(part 1 of 2)
# Autodesk Inventor assembly: Z-Axis
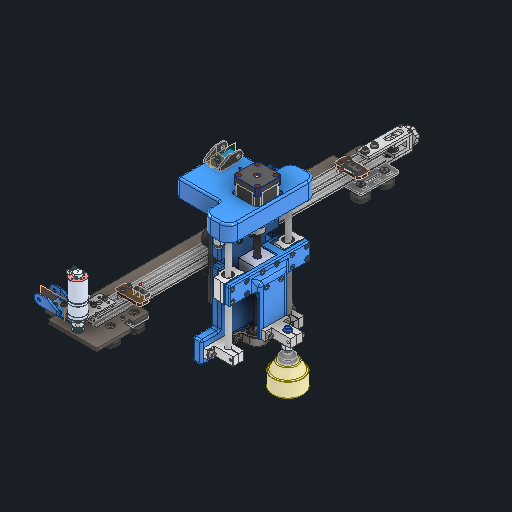
[picture p0: Inventor's stored thumbnail of the model, 512x512]
Saved by Autodesk Inventor 2027.1 (Build 311270010, 270A)
## iProperties
Created: 2026-10-04
Part Number: Z-Axis
Document SubType Name: Assembly
Designer: Ahmed
Author: Ahmed
## iProperties of the stored document nippel.ipt
Created: 2014-03-17
Part Number: nippel
Material: Generic
Document SubType Name: Modeling
Designer: Ahmed
Density: 1 g/cm^3
Appearance: Default
Mass: 1.51643 g
Surface Area: 12.4065 cm^2
Volume: 1.51643 cm^3
Sending System: SOLIDWORKS 2012
Last Saved Date: 2014-05-13
last saved by: Oleg
Author: Ahmed
## iProperties of the stored document Gantry_Plate_65x65.ipt
Created: 2024-03-15
Part Number: Gantry_Plate_65x65
Material: Generic
Description: STEP AP214
Document SubType Name: Modeling
Designer: Ahmed
Density: 1 g/cm^3
Appearance: Default
Mass: 10.5497 g
Surface Area: 93.2193 cm^2
Volume: 10.5497 cm^3
Sending System: SolidWorks 2024
Preprocessor: SwSTEP 2.0
Title: Gantry_Plate_65x65.STEP
Revision Number: ANY
## iProperties of the stored document IPCF06-02.iam
Company: Open CASCADE
Created: 2026-10-23
Part Number: IPCF06-02
Description: Open CASCADE Model
Document SubType Name: Assembly
Designer: Ahmed
Authority: Unknown
Mass: 1.21454 g
Surface Area: 16.1477 cm^2
Volume: 1.21454 cm^3
Density: 1 g/cm^3
Sending System: Open CASCADE 7.9
Preprocessor: Open CASCADE STEP processor 7.9
Title: Open CASCADE Shape Model
Author: Author
## iProperties of the stored document Insert M3 D5 L5mm.ipt
Created: 2022-05-23
Part Number: Document
Material: Generic
Document SubType Name: Modeling
Designer: Ahmed
Density: 1 g/cm^3
Appearance: Default
Mass: 0.0567155 g
Surface Area: 2.1125 cm^2
Volume: 0.0567155 cm^3
Preprocessor: ST-DEVELOPER v16.5
Title: Insert M3 D5 L5mm
Revision Number: AFirst version
## iProperties of the stored document Suction-ohne-nippel.ipt
Created: 2014-03-17
Part Number: Suction-ohne-nippel
Material: Generic
Document SubType Name: Modeling
Designer: Ahmed
Density: 1 g/cm^3
Appearance: Default
Mass: 1.14453 g
Surface Area: 25.0648 cm^2
Volume: 1.14453 cm^3
Sending System: SOLIDWORKS 2012
Last Saved Date: 2014-05-13
last saved by: Oleg
Author: Ahmed
## iProperties of the stored document release_ring.ipt
Created: 2026-10-23
Part Number: release_ring
Material: Generic
Document SubType Name: Modeling
Designer: Ahmed
Density: 1 g/cm^3
Appearance: Default
Mass: 0.104785 g
Surface Area: 2.06972 cm^2
Volume: 0.104785 cm^3
Author: Ahmed
## iProperties of the stored document Suction.iam
Created: 2014-03-17
Part Number: Suction
Document SubType Name: Assembly
Designer: Ahmed
Mass: 2.66095 g
Surface Area: 37.4713 cm^2
Volume: 2.66095 cm^3
Density: 1 g/cm^3
Sending System: SOLIDWORKS 2012
last saved by: Oleg
Last Saved Date: 2014-05-13
Author: Ahmed
## iProperties of the stored document body.ipt
Created: 2026-10-23
Part Number: body
Material: Generic
Document SubType Name: Modeling
Designer: Ahmed
Density: 1 g/cm^3
Appearance: Default
Mass: 1.10976 g
Surface Area: 14.0779 cm^2
Volume: 1.10976 cm^3
Author: Ahmed
## Documents named in this file (81)
- C:\Users\Ahmed\Desktop\Fall 26\Design 1 Repo\MCT333_Design_of_Mechatronics_Systems_1\CAD\cartesian_robot_workspace\Z_Axis_1\Z-Axis.iam
- C:\Users\Ahmed\Desktop\Fall 26\Design 1 Repo\MCT333_Design_of_Mechatronics_Systems_1\CAD\cartesian_robot_workspace\Z_Axis_1\AluminumExtrusion\AluminumExtrusion\AluminiumExtrusion2020\2020extrusion_ipt\2020aluminum_extrusion_black.ipt
- C:\Users\Ahmed\Desktop\Fall 26\Design 1 Repo\MCT333_Design_of_Mechatronics_Systems_1\CAD\cartesian_robot_workspace\Z_Axis_1\V-Pulley.ipt
- C:\Users\Ahmed\Desktop\Fall 26\Design 1 Repo\MCT333_Design_of_Mechatronics_Systems_1\CAD\cartesian_robot_workspace\Z_Axis_1\VSoltGantrySetAllSizes\VSoltGantrySetAllSizes\40mm Gantry Set universal\127x88 Gantry.ipt
- C:\Users\Ahmed\Desktop\Fall 26\Design 1 Repo\MCT333_Design_of_Mechatronics_Systems_1\CAD\cartesian_robot_workspace\Z_Axis_1\sk8-linear-shaft-support-8mm-1.snapshot.1\SK8 Linear Shaft Support, 8mm v4\SK8 Linear Shaft Support, 8mm v4.ipt
- C:\Users\Ahmed\Desktop\Fall 26\Design 1 Repo\MCT333_Design_of_Mechatronics_Systems_1\CAD\cartesian_robot_workspace\Z_Axis_1\scs8uu-linear-bearing-block-8mm-shaft-1.snapshot.1\SCS8UU Block, Linear Bearing, 8mm Shaft v4\SCS8UU Block, Linear Bearing, 8mm.ipt
- C:\Users\Ahmed\Desktop\Fall 26\Design 1 Repo\MCT333_Design_of_Mechatronics_Systems_1\CAD\cartesian_robot_workspace\Z_Axis_1\shf10-shf8-linear-shaft-support-1.snapshot.6\SHF8\SHF8.ipt
- C:\Users\Ahmed\Desktop\Fall 26\Design 1 Repo\MCT333_Design_of_Mechatronics_Systems_1\CAD\cartesian_robot_workspace\Z_Axis_1\KP08 Pillow block bearing 08mm diameter\KP08 Pillow block bearing 08mm diameter.ipt
- C:\Users\Ahmed\Desktop\Fall 26\Design 1 Repo\MCT333_Design_of_Mechatronics_Systems_1\CAD\cartesian_robot_workspace\Z_Axis_1\nema-17-40mm-stepper-motor-1.snapshot.22\17HM15-0904S\17HM15-0904S\17HM15-0904S.ipt
- C:\Users\Ahmed\Desktop\Fall 26\Design 1 Repo\MCT333_Design_of_Mechatronics_Systems_1\CAD\cartesian_robot_workspace\Z_Axis_1\aluminum-flexible-shaft-coupling-5mm-x-8mm-1.snapshot.1\Flexible Shaft Coupling 5mm to 8mm\Flexible_Shaft_Coupling_5_to_8mm v7.ipt
- C:\Users\Ahmed\Desktop\Fall 26\Design 1 Repo\MCT333_Design_of_Mechatronics_Systems_1\CAD\cartesian_robot_workspace\Z_Axis_1\Z Bracket.ipt
- C:\Users\Ahmed\Desktop\Fall 26\Design 1 Repo\MCT333_Design_of_Mechatronics_Systems_1\CAD\cartesian_robot_workspace\Z_Axis_1\tr8x8-4-8mm-4-start-lead-screw-1.snapshot.6\Trapezoidal lead screw tr8x8-4\Trapezoidal lead screw tr8x8-4.ipt
- C:\Users\Ahmed\Desktop\Fall 26\Design 1 Repo\MCT333_Design_of_Mechatronics_Systems_1\CAD\cartesian_robot_workspace\Z_Axis_1\shf10-shf8-linear-shaft-support-1.snapshot.6\SHF8\SHF8_MIR.ipt
- C:\Users\Ahmed\Desktop\Fall 26\Design 1 Repo\MCT333_Design_of_Mechatronics_Systems_1\CAD\cartesian_robot_workspace\Z_Axis_1\Linear Guide Rods.ipt
- C:\Users\Ahmed\Documents\Inventor\Content Center Files\R2027\en-US\ISO 4032(2)\ISO 4032 - M5 - ISO.ipt
- C:\Users\Ahmed\Documents\Inventor\Content Center Files\R2027\en-US\ISO 4762(2)\ISO 4762 - M5 x 16ISO.ipt
- C:\Users\Ahmed\Desktop\Fall 26\Design 1 Repo\MCT333_Design_of_Mechatronics_Systems_1\CAD\cartesian_robot_workspace\Z_Axis_1\Bearing Spacer.ipt
- C:\Users\Ahmed\Desktop\Fall 26\Design 1 Repo\MCT333_Design_of_Mechatronics_Systems_1\CAD\cartesian_robot_workspace\Z_Axis_1\Insert M5 D7 L9.5mm\Insert M5 D7 L9.5mm.ipt
- C:\Users\Ahmed\Desktop\Fall 26\Design 1 Repo\MCT333_Design_of_Mechatronics_Systems_1\CAD\cartesian_robot_workspace\Z_Axis_1\M4 Insert\M4 Insert.ipt
- C:\Users\Ahmed\Documents\Inventor\Content Center Files\R2027\en-US\ISO 4762(2)\ISO 4762 - M5 x 20ISO.ipt
- C:\Users\Ahmed\Documents\Inventor\Content Center Files\R2027\en-US\ISO 4762(2)\ISO 4762 - M4 x 16ISO.ipt
- C:\Users\Ahmed\Desktop\Fall 26\Design 1 Repo\MCT333_Design_of_Mechatronics_Systems_1\CAD\cartesian_robot_workspace\Z_Axis_1\Linear Bearing Spacer.ipt
- C:\Users\Ahmed\Desktop\Fall 26\Design 1 Repo\MCT333_Design_of_Mechatronics_Systems_1\CAD\cartesian_robot_workspace\Z_Axis_1\T8 nut\T8 nut.ipt
- C:\Users\Ahmed\Documents\Inventor\Content Center Files\R2027\en-US\ISO 4762(2)\ISO 4762 - M3 x 12ISO.ipt
- C:\Users\Ahmed\Desktop\Fall 26\Design 1 Repo\MCT333_Design_of_Mechatronics_Systems_1\CAD\cartesian_robot_workspace\Z_Axis_1\NO-NC Bump Switch\NO-NC Bump Switch.ipt
- C:\Users\Ahmed\Desktop\Fall 26\Design 1 Repo\MCT333_Design_of_Mechatronics_Systems_1\CAD\cartesian_robot_workspace\Z_Axis_1\Limit Switch Spacer.ipt
- C:\Users\Ahmed\Desktop\Fall 26\Design 1 Repo\MCT333_Design_of_Mechatronics_Systems_1\CAD\cartesian_robot_workspace\Z_Axis_1\SK12 SHAFT HOLDER\SK12 SHAFT HOLDER.ipt
- C:\Users\Ahmed\Desktop\Fall 26\Design 1 Repo\MCT333_Design_of_Mechatronics_Systems_1\CAD\cartesian_robot_workspace\Z_Axis_1\Suction Cup Fixation.ipt
- **C:\Users\Ahmed\Desktop\Fall 26\Design 1 Repo\MCT333_Design_of_Mechatronics_Systems_1\CAD\cartesian_robot_workspace\Z_Axis_1\Z-Axis.iam*LocalDocs*xAaaaqrcaAaaaaaaaAaaaavx32f*Suction.iam
- C:\Users\Ahmed\Documents\Inventor\Content Center Files\R2027\en-US\ISO 4762(2)\ISO 4762 - M4 x 12ISO.ipt
- C:\Users\Ahmed\Documents\Inventor\Content Center Files\R2027\en-US\ISO 4762(2)\ISO 4762 - M4 x 8ISO.ipt
- C:\Users\Ahmed\Desktop\Fall 26\Design 1 Repo\MCT333_Design_of_Mechatronics_Systems_1\CAD\cartesian_robot_workspace\Z_Axis_1\Product Base.ipt
- **C:\Users\Ahmed\Desktop\Fall 26\Design 1 Repo\MCT333_Design_of_Mechatronics_Systems_1\CAD\cartesian_robot_workspace\Z_Axis_1\Z-Axis.iam*LocalDocs*xAaaaa4daAaaaaaaaAaaaqi4fEb*IPCF06-02.iam
- C:\Users\Ahmed\Documents\Inventor\Content Center Files\R2027\en-US\ANSI B18.22 M\ANSI B18.22M - 5 N.ipt
- C:\Users\Ahmed\Documents\Inventor\Content Center Files\R2027\en-US\ISO 4032(2)\ISO 4032 - M2 - ISO.ipt
- C:\Users\Ahmed\Documents\Inventor\Content Center Files\R2027\en-US\ANSI B18.22 M\ANSI B18.22M - 2 N.ipt
- C:\Users\Ahmed\Documents\Inventor\Content Center Files\R2027\en-US\ISO 4762(2)\ISO 4762 - M2 x 16ISO.ipt
- **C:\Users\Ahmed\Desktop\Fall 26\Design 1 Repo\MCT333_Design_of_Mechatronics_Systems_1\CAD\cartesian_robot_workspace\Z_Axis_1\Z-Axis.iam*LocalDocs*xAaaaq5baAaaaaaaaAaaaqochXh*Insert M3 D5 L5mm.ipt
- C:\Users\Ahmed\Documents\Inventor\Content Center Files\R2027\en-US\ANSI B18.22 M\ANSI B18.22M - 3 N.ipt
- **C:\Users\Ahmed\Desktop\Fall 26\Design 1 Repo\MCT333_Design_of_Mechatronics_Systems_1\CAD\cartesian_robot_workspace\Z_Axis_1\Z-Axis.iam*LocalDocs*xAaaaq4baAaaaaaaaAaaaa31b2g*Gantry_Plate_65x65.ipt
- C:\Users\Ahmed\Desktop\Fall 26\Design 1 Repo\MCT333_Design_of_Mechatronics_Systems_1\CAD\cartesian_robot_workspace\Z_Axis_1\Drag Chain Support.ipt
- C:\Users\Ahmed\Desktop\Fall 26\Design 1 Repo\MCT333_Design_of_Mechatronics_Systems_1\CAD\cartesian_robot_workspace\Z_Axis_1\Drag Chain Start Link.ipt
- C:\Users\Ahmed\Desktop\Fall 26\Design 1 Repo\MCT333_Design_of_Mechatronics_Systems_1\CAD\cartesian_robot_workspace\Z_Axis_1\GT2 Belt 6mm x 40mm\GT2 Belt 6mm x 40mm.ipt
- C:\Users\Ahmed\Documents\Inventor\Content Center Files\R2027\en-US\ISO 4032(2)\ISO 4032 - M3 - ISO.ipt
- C:\Users\Ahmed\Desktop\Fall 26\Design 1 Repo\MCT333_Design_of_Mechatronics_Systems_1\CAD\cartesian_robot_workspace\Z_Axis_1\motor holder bracket.ipt
- C:\Users\Ahmed\Desktop\Fall 26\Design 1 Repo\MCT333_Design_of_Mechatronics_Systems_1\CAD\cartesian_robot_workspace\Z_Axis_1\Slider T-Nut for 2020 - M3.ipt
- C:\Users\Ahmed\Desktop\Fall 26\Design 1 Repo\MCT333_Design_of_Mechatronics_Systems_1\CAD\cartesian_robot_workspace\Z_Axis_1\Motor.ipt
- C:\Users\Ahmed\Desktop\Fall 26\Design 1 Repo\MCT333_Design_of_Mechatronics_Systems_1\CAD\cartesian_robot_workspace\Z_Axis_1\GT2 Pulley Assembly With Grub Screws\GT2 Pulley Assembly With Grub Screws.ipt
- C:\Users\Ahmed\Documents\Inventor\Content Center Files\R2027\en-US\ISO 7045  Z\ISO 7045 - M2 x 10_ - 4.8 - Z - ISO.ipt
- C:\Users\Ahmed\Desktop\Fall 26\Design 1 Repo\MCT333_Design_of_Mechatronics_Systems_1\CAD\cartesian_robot_workspace\Z_Axis_1\DC Motor Bracket Spacer.ipt
- C:\Users\Ahmed\Desktop\Fall 26\Design 1 Repo\MCT333_Design_of_Mechatronics_Systems_1\CAD\cartesian_robot_workspace\Z_Axis_1\Slider T-Nut for 2020 - M5.ipt
- C:\Users\Ahmed\Documents\Inventor\Content Center Files\R2027\en-US\ISO 4762(2)\ISO 4762 - M5 x 10ISO.ipt
- C:\Users\Ahmed\Desktop\Fall 26\Design 1 Repo\MCT333_Design_of_Mechatronics_Systems_1\CAD\cartesian_robot_workspace\Z_Axis_1\LimitSwitchMountPlate.ipt
- C:\Users\Ahmed\Desktop\Fall 26\Design 1 Repo\MCT333_Design_of_Mechatronics_Systems_1\CAD\cartesian_robot_workspace\Z_Axis_1\2020 Belt Tensioner G_K.ipt
- C:\Users\Ahmed\Desktop\Fall 26\Design 1 Repo\MCT333_Design_of_Mechatronics_Systems_1\CAD\cartesian_robot_workspace\Z_Axis_1\M4 T slot nut - 2020\M4 T slot nut - 2020.ipt
- C:\Users\Ahmed\Documents\Inventor\Content Center Files\R2027\en-US\ANSI B18.22 M\ANSI B18.22M - 4 N.ipt
- C:\Users\Ahmed\Documents\Inventor\Content Center Files\R2027\en-US\ISO 4762(2)\ISO 4762 - M3 x 10ISO.ipt
- C:\Users\Ahmed\Desktop\Fall 26\Design 1 Repo\MCT333_Design_of_Mechatronics_Systems_1\CAD\cartesian_robot_workspace\Z_Axis_1\Path.ipt
- C:\Users\Ahmed\Desktop\Fall 26\Design 1 Repo\MCT333_Design_of_Mechatronics_Systems_1\CAD\cartesian_robot_workspace\Z_Axis_1\Drag Chain Middle Link.ipt
- C:\Users\Ahmed\Documents\Inventor\Content Center Files\R2027\en-US\ISO 4026\ISO 4026 - M3 x 16 - ISO.ipt
- C:\Users\Ahmed\Documents\Inventor\Content Center Files\R2027\en-US\ISO 7045  Z\ISO 7045 - M3 x 16_ - 4.8 - Z - ISO.ipt
- C:\Users\Ahmed\Documents\Inventor\Content Center Files\R2027\en-US\ISO 7380-1\ISO 7380-1 - M3 x 16.ipt
- C:\Users\Ahmed\Desktop\Fall 26\Design 1 Repo\MCT333_Design_of_Mechatronics_Systems_1\CAD\cartesian_robot_workspace\Z_Axis_1\90 Degree Drag Chain Link.ipt
- C:\Users\Ahmed\Desktop\Fall 26\Design 1 Repo\MCT333_Design_of_Mechatronics_Systems_1\CAD\en-US\en-US\ISO 4762(2)\ISO 4762 - M3 x 16ISO.ipt
- C:\Users\Ahmed\Desktop\Fall 26\Design 1 Repo\MCT333_Design_of_Mechatronics_Systems_1\CAD\cartesian_robot_workspace\Z_Axis_1\LimitSwitchMountPlate_MIR.ipt
- C:\Users\Ahmed\Desktop\Fall 26\Design 1 Repo\MCT333_Design_of_Mechatronics_Systems_1\CAD\cartesian_robot_workspace\Z_Axis_1\NO-NC Bump Switch\NO-NC Bump Switch_MIR.ipt
- C:\Users\Ahmed\Desktop\Fall 26\Design 1 Repo\MCT333_Design_of_Mechatronics_Systems_1\CAD\cartesian_robot_workspace\Z_Axis_1\Slider T-Nut for 2020 - M3_MIR.ipt
- C:\Users\Ahmed\Desktop\Fall 26\Design 1 Repo\MCT333_Design_of_Mechatronics_Systems_1\CAD\off_the_shelf_components\Tr8 Guide Nut and Housing\t8_nut_housing.ipt
- C:\Users\Ahmed\Desktop\Fall 26\Design 1 Repo\MCT333_Design_of_Mechatronics_Systems_1\CAD\cartesian_robot_workspace\Z_Axis_1\Insert M3 D5 L5mm.stp
- **C:\Users\Ahmed\Desktop\Fall 26\MCT333 Design of Mechatronics Systems 1\Project\CAD\Z-Axis.iam*LocalDocs*xAaaaqcaaAaaaaaaaAaaaartaHg*nippel.ipt
- **C:\Users\Ahmed\Desktop\Fall 26\MCT333 Design of Mechatronics Systems 1\Project\CAD\Z-Axis.iam*LocalDocs*xAaaaa4daAaaaaaaaAaaaqi4fEb*IPCF06-02.iam
- **C:\Users\Ahmed\Desktop\Fall 26\MCT333 Design of Mechatronics Systems 1\Project\CAD\Z-Axis.iam*LocalDocs*xAaaaqzaaAaaaaaaaAaaaqmsjBh*body.ipt
- **C:\Users\Ahmed\Desktop\Fall 26\MCT333 Design of Mechatronics Systems 1\Project\CAD\Z-Axis.iam*LocalDocs*xAaaaqibaAaaaaaaaAaaaq5znNd*release_ring.ipt
- **C:\Users\Ahmed\Desktop\Fall 26\MCT333 Design of Mechatronics Systems 1\Project\CAD\Z-Axis.iam*LocalDocs*xAaaaq5baAaaaaaaaAaaaqochXh*Insert M3 D5 L5mm.ipt
- **C:\Users\Ahmed\Desktop\Fall 26\MCT333 Design of Mechatronics Systems 1\Project\CAD\Z-Axis.iam*LocalDocs*xAaaaqocaAaaaaaaaAaaaahhiSh*Suction-ohne-nippel.ipt
- **C:\Users\Ahmed\Desktop\Fall 26\MCT333 Design of Mechatronics Systems 1\Project\CAD\Z-Axis.iam*LocalDocs*xAaaaqrcaAaaaaaaaAaaaavx32f*Suction.iam
- C:\Users\Ahmed\Desktop\Fall 26\Design 1 Repo\MCT333_Design_of_Mechatronics_Systems_1\CAD\cartesian_robot_workspace\Z_Axis_1\Suction.SLDASM
- C:\Users\Ahmed\Desktop\Fall 26\Design 1 Repo\MCT333_Design_of_Mechatronics_Systems_1\CAD\cartesian_robot_workspace\Z_Axis_1\nippel.SLDPRT
- C:\Users\Ahmed\Desktop\Fall 26\Design 1 Repo\MCT333_Design_of_Mechatronics_Systems_1\CAD\cartesian_robot_workspace\Z_Axis_1\Suction-ohne-nippel.SLDPRT
- C:\Users\Ahmed\Desktop\Fall 26\Design 1 Repo\MCT333_Design_of_Mechatronics_Systems_1\CAD\cartesian_robot_workspace\Z_Axis_1\IPCF06-02.step
- C:\Users\Ahmed\Desktop\Fall 26\Design 1 Repo\MCT333_Design_of_Mechatronics_Systems_1\CAD\cartesian_robot_workspace\Z_Axis_1\Gantry_Plate_65x65.STEP
## Components (267 placed, 67 different names)
1. 2020aluminum_extrusion_black:1 — Tangent:9, Tangent:10, Tangent:11, Tangent:12, Mate:245, Mate:246, Mate:247, Mate:252, Flush:22, Flush:23, Angle:11, Flush:26, Flush:308, Mate:307, Mate:308, Mate:322, Mate:343, Angle:14, Mate:353, Mate:369, Mate:372, Mate:373, Mate:374, Mate:393, Mate:394, Mate:395, Mate:396, Angle:16, Angle:17, Mate:398, Mate:399, Mate:400, Flush:310, Angle:18, Mate:403, Mate:404, Mate:423, Mate:424, Angle:21, Angle:22, Flush:309, Mate:477
2. SCS8UU Block, Linear Bearing, 8mm:1 — Mate:34, Mate:78, Mate:531
3. 17HS4401:1 — Mate:7, Mate:8, Mate:224, Mate:225
4. Flexible_Shaft_Coupling_5_to_8mm v7:1 — Mate:8, Mate:10, Mate:12, Mate:33
5. Z Bracket:1 — Mate:2, Mate:3, Mate:4, Mate:7, Mate:10, Mate:18, Mate:19, Mate:20, Mate:21, Mate:22, Mate:26, Mate:27, Mate:28, Mate:30, Mate:32, Angle:6, Mate:38, Angle:7, Mate:41, Mate:42, Mate:43, Mate:44, Mate:45, Mate:47, Mate:48, Mate:49, Mate:50, Mate:51, Mate:52, Mate:53, Flush:7, Mate:54, Flush:8, Mate:55, Flush:9, Mate:56, Flush:10, Mate:57, Mate:58, Mate:59, Mate:60, Flush:11, Flush:12, Flush:13, Flush:14, Mate:61, Mate:62, Flush:15, Flush:16, Insert:15, Insert:16, Insert:17, Insert:18, Insert:23, Insert:24, Insert:25, Insert:26, Insert:29, Insert:30, Insert:31, Insert:32, Insert:35, Insert:36, Mate:206, Mate:209, Mate:210, Angle:8, Mate:217, Insert:37, Insert:38, Mate:235, Flush:17, Mate:236, Flush:18, Flush:25, Mate:443, Mate:530
6. Trapezoidal lead screw tr8x8-4:1 — Mate:12, Mate:33, Mate:534
7. SCS8UU Block, Linear Bearing, 8mm:2 — Mate:35, Mate:75, Mate:76
8. M4 Insert:1 — Mate:61, Flush:16
9. M4 Insert:2 — Mate:62, Flush:15
10. ISO 4762 M3 x 16:8 — Insert:23
11. ISO 4762 M3 x 16:9 — Insert:24, Mate:225
12. ISO 4762 M3 x 16:10 — Insert:25, Mate:224
13. ISO 4762 M3 x 16:11 — Insert:26
14. Linear Bearing Spacer:1 — Mate:78, Mate:148, Mate:149, Mate:531, Mate:535
15. Linear Bearing Spacer:2 — Mate:75, Mate:76, Mate:108, Mate:179
16. T8 nut:1 — Mate:84, Mate:85, Mate:86, Mate:87, Mate:532, Mate:533, Insert:56, Insert:57, Mate:534
17. ISO 4762 M3 x 12:1 — Mate:84, Mate:87
18. ISO 4762 M3 x 12:2 — Mate:85, Mate:86
19. SK12 SHAFT HOLDER:1 — Mate:110, Mate:111, Mate:112, Mate:113, Mate:114, Mate:134, Mate:135, Mate:136, Mate:137, Mate:146, Insert:47
20. Suction Cup Fixation:1 — Mate:108, Mate:110, Mate:111, Mate:112, Mate:118, Mate:119, Mate:120, Mate:121, Mate:122, Mate:123, Mate:124, Mate:125, Mate:126, Mate:127, Mate:128, Mate:129, Mate:130, Mate:131, Mate:132, Mate:133, Mate:150, Mate:151, Mate:152, Mate:153, Mate:154, Mate:155, Mate:156, Mate:157, Insert:33, Insert:34, Mate:535, Mate:536
21. Suction:1 [sub-assembly] — Mate:113, Mate:114, Mate:144, Mate:145, Mate:147
22. ISO 4762 M4 x 12:2 — Mate:118, Mate:120
23. ISO 4762 M4 x 12:1 — Mate:119, Mate:121
24. ISO 4762 M4 x 12:3 — Mate:123, Mate:124, Mate:149
25. ISO 4762 M4 x 12:4 — Mate:122, Mate:125, Mate:148
26. ISO 4762 M4 x 12:5 — Mate:151, Mate:155, Mate:179
27. ISO 4762 M4 x 8:3 — Mate:126, Mate:127, Mate:537
28. ISO 4762 M4 x 8:4 — Mate:128, Mate:129
29. ISO 4762 M4 x 16:6 — Mate:130, Mate:133
30. ISO 4762 M4 x 16:7 — Mate:131, Mate:132
31. ISO 4762 M5 x 20:14 — Mate:134, Mate:135, Mate:158
32. ISO 4762 M5 x 20:13 — Mate:136, Mate:137, Mate:160
33. Product Base:1 — Mate:144, Mate:145
34. IPCF06-02:1 [sub-assembly] — Mate:146, Mate:147
35. ISO 4762 M4 x 12:6 — Mate:150, Mate:154
36. ISO 4762 M4 x 12:7 — Mate:152, Mate:157
37. ISO 4762 M4 x 12:8 — Mate:153, Mate:156
38. ISO 4032 M5:13 — Mate:158, Mate:161
39. ISO 4032 M5:14 — Mate:160, Mate:162
40. Plain Washer (Metric) 5 N:1 — Insert:33, Mate:161
41. Plain Washer (Metric) 5 N:2 — Insert:34, Mate:162
42. Limit Switch Spacer:1 — Mate:206, Mate:207, Mate:208, Mate:211
43. Insert M3 D5 L5mm:1 — Mate:235, Flush:17, Mate:238
44. Insert M3 D5 L5mm:2 — Mate:236, Flush:18, Mate:237
45. ISO 4762 M3 x 12:3 — Mate:238, Mate:242, Mate:244, Mate:478
46. ISO 4762 M3 x 12:4 — Mate:237, Mate:239, Mate:240, Mate:442, Mate:479
47. Plain Washer (Metric) 3 N:2 — Mate:242, Mate:244, Mate:444
48. Plain Washer (Metric) 3 N:1 — Mate:239, Mate:240, Mate:445
49. Gantry_Plate_65x65:2 — Mate:245, Mate:246, Mate:247, Mate:291, Insert:48, Insert:49, Insert:50, Insert:51, Mate:348, Mate:351, Mate:354, Mate:356, Mate:359, Mate:367, Mate:370, Mate:397, Flush:309, Mate:453, Mate:455, Mate:472, Mate:529, Symmetry:1
50. Drag Chain Support:1 — Mate:252, Mate:358, Mate:359, Mate:405, Mate:406, Angle:23, Mate:470, Mate:473, Mate:474, Mate:475, Mate:476, Mate:483, Mate:487, Mate:497, Mate:500, Mate:507, Mate:516, Mate:517, Mate:518, Mate:519, Mate:527, Mate:528
51. GT2 Belt 6mm x 40mm:1 — Flush:21, Flush:22
52. GT2 Belt 6mm x 40mm:2 — Flush:23, Flush:24
53. ISO 4762 M4 x 16:8 — Insert:47
54. ISO 4762 M2 x 16:5 — Mate:291, Mate:293
55. ISO 4032 M2:5 — Mate:348
56. Plain Washer (Metric) 2 N:6 — Mate:293
57. motor holder bracket:1 — Angle:11, Flush:26, Mate:305, Mate:306, Mate:309, Mate:311, Mate:313, Mate:315, Mate:317, Mate:319, Mate:320, Mate:336, Mate:337, Mate:341, Mate:344, Mate:345, Mate:346, Mate:347, Mate:378
58. Slider T-Nut for 2020 - M3:1 — Mate:305, Flush:308, Mate:307, Angle:12
59. Slider T-Nut for 2020 - M3:2 — Mate:306, Angle:12, Mate:308
60. ISO 4762 M3 x 12:5 — Mate:309, Mate:310, Mate:312
61. ISO 4762 M3 x 12:6 — Mate:313, Mate:314, Mate:316
62. Plain Washer (Metric) 3 N:7 — Mate:310, Mate:311, Mate:312
63. Plain Washer (Metric) 3 N:8 — Mate:314, Mate:315, Mate:316
64. Motor:1 — Mate:317, Mate:319, Mate:320, Mate:321
65. GT2 Pulley Assembly With Grub Screws:1 — Mate:321, Mate:322
66. ISO 7045 Z M2 x 10 - 4.8 - Z:4 — Mate:332, Mate:334, Mate:345
67. Plain Washer (Metric) 2 N:13 — Mate:332, Mate:334, Mate:346
68. ISO 7045 Z M2 x 10 - 4.8 - Z:1 — Mate:333, Mate:335, Mate:344
69. Plain Washer (Metric) 2 N:14 — Mate:333, Mate:335, Mate:347
70. DC Motor Bracket Spacer:1 — Mate:336, Mate:337, Mate:339, Mate:340, Mate:341, Mate:342
71. DC Motor Bracket Spacer:2 — Mate:339, Mate:340, Mate:342, Mate:343
72. V-Pulley:5 — Insert:48
73. V-Pulley:6 — Insert:51, Mate:358
74. V-Pulley:7 — Insert:50
75. V-Pulley:8 — Insert:49
76. Slider T-Nut for 2020 - M5:1 — Mate:351, Angle:14, Mate:353
77. ISO 4762 M5 x 10:5 — Mate:354, Mate:355, Mate:357
78. Plain Washer (Metric) 5 N:19 — Mate:355, Mate:356, Mate:357
79. Slider T-Nut for 2020 - M5:2 — Mate:368, Mate:369
80. ISO 4762 M5 x 10:6 — Mate:367, Mate:368
81. Plain Washer (Metric) 5 N:20 — Mate:370
82. Gantry_Plate_65x65:3 — Mate:397, Mate:398, Mate:410, Symmetry:1
83. ISO 4762 M3 x 16:12 — Mate:405, Mate:409
84. ISO 4032 M3:12 — Mate:411
85. Plain Washer (Metric) 3 N:9 — Mate:406
86. V-Pulley:9
87. V-Pulley:10
88. V-Pulley:11
89. V-Pulley:12
90. Slider T-Nut for 2020 - M5:3 — Mate:394, Mate:396, Angle:17
91. ISO 4762 M5 x 10:7
92. Plain Washer (Metric) 5 N:21
93. Slider T-Nut for 2020 - M5:4 — Mate:393, Mate:395, Angle:16
94. ISO 4762 M5 x 10:8
95. Plain Washer (Metric) 5 N:22
96. 2020 Belt Tensioner G_K:1 — Mate:399, Mate:400, Flush:310, Mate:401, Mate:402, Angle:19, Mate:407, Mate:408, Mate:414, Mate:415
97. M4 T slot nut - 2020:1 — Mate:401, Angle:18, Mate:404
98. M4 T slot nut - 2020:2 — Mate:402, Angle:19, Mate:403
99. ISO 4762 M4 x 12:9 — Mate:407, Mate:412, Mate:417
100. ISO 4762 M4 x 12:10 — Mate:408, Mate:413, Mate:416
101. Plain Washer (Metric) 3 N:10 — Mate:409, Mate:410, Mate:411
102. Plain Washer (Metric) 4 N:1 — Mate:412, Mate:414, Mate:417
103. Plain Washer (Metric) 4 N:2 — Mate:413, Mate:415, Mate:416
104. Drag Chain Start Link:2 — Mate:474, Mate:475, Mate:476, Mate:477, Flush:311, Mate:484, Mate:498
105. Drag Chain Start Link:3 — Mate:442, Mate:443, Mate:444, Mate:445, Mate:478, Mate:479, Flush:311, Flush:313
106. Path:1 — Mate:447
107. ISO 4026 M3 x 16:1 — Mate:450
108. ISO 4032 M3:3 — Mate:450, Mate:459
109. ISO 7045 Z M3 x 16 - 4.8 - Z:1 — Mate:453
110. ISO 7380-1 M3 x 16:1 — Mate:455, Mate:457
111. Plain Washer (Metric) 3 N:13 — Mate:457, Mate:459
112. ISO 4762 M3 x 12:7 — Mate:470, Mate:473
113. ISO 4032 M3:13
114. Plain Washer (Metric) 3 N:15 — Mate:472
115. ISO 4762 M3 x 12:8 — Mate:483, Mate:486, Mate:508
116. Plain Washer (Metric) 3 N:16 — Mate:484
117. ISO 4032 M3:14 — Mate:486, Mate:487
118. ISO 4762 M3 x 12:10 — Mate:497, Mate:499
119. Plain Washer (Metric) 3 N:18 — Mate:498
120. ISO 4032 M3:15 — Mate:499, Mate:500
121. 90 Degree Drag Chain Link:1 — Flush:313, Mate:507, Mate:508, Mate:515, Mate:520, Mate:521
122. ISO 4762 M3 x 12:12 — Mate:517
123. Plain Washer (Metric) 3 N:20 — Mate:521
124. ISO 4032 M3:16 — Mate:519
125. ISO 4762 M3 x 12:13 — Mate:515, Mate:516
126. Plain Washer (Metric) 3 N:21 — Mate:520
127. ISO 4032 M3:17 — Mate:518
128. ISO 4762 M3 x 16:13 — Mate:527
129. ISO 4032 M3:18
130. Plain Washer (Metric) 3 N:22 — Mate:528
131. Plain Washer (Metric) 3 N:23 — Mate:529
132. t8_nut_housing:1 — Mate:532, Mate:533, Mate:536, Mate:537
133. ISO 4762 M3 x 12:14 — Insert:56
134. ISO 4762 M3 x 12:15 — Insert:57
135. Plain Washer (Metric) 2 N:5 — Mate:233
136. Plain Washer (Metric) 2 N:4 — Mate:234
137. Limit Switch Spacer:2 — Mate:213, Mate:214, Mate:216, Angle:8, Mate:217
138. NO-NC Bump Switch:2 — Mate:213, Mate:214, Mate:216, Mate:219, Mate:231, Mate:232, Mate:233, Mate:234, Flush:25
139. ISO 4032 M2:3 — Insert:37
140. ISO 4032 M2:4 — Insert:38
141. ISO 4762 M2 x 16:3 — Mate:231
142. ISO 4762 M2 x 16:4 — Mate:232
143. NO-NC Bump Switch:3 — Mate:197, Mate:198, Mate:201, Mate:203, Mate:211
144. ISO 4032 M2:2 — Insert:36
145. ISO 4032 M2:1 — Insert:35
146. ISO 4762 M2 x 16:2 — Mate:197, Mate:200, Mate:205, Mate:208, Mate:210
147. ISO 4762 M2 x 16:1 — Mate:198, Mate:202, Mate:204, Mate:207, Mate:209
148. Plain Washer (Metric) 2 N:2 — Mate:200, Mate:201, Mate:205
149. Plain Washer (Metric) 2 N:3 — Mate:202, Mate:203, Mate:204
150. 127x88 Gantry:1 — Insert:2, Insert:4, Mate:2, Mate:3, Mate:4, Insert:27, Insert:28, Mate:164, Mate:168, Mate:169, Mate:170, Mate:175, Mate:176, Mate:177, Mate:178, Flush:21, Flush:24
151. V-Pulley:1 — Insert:2
152. V-Pulley:2 — Insert:4
153. V-Pulley:3 — Insert:28, Tangent:11, Tangent:12
154. V-Pulley:4 — Insert:27, Tangent:9, Tangent:10
155. ISO 4762 M5 x 20:11 — Insert:30, Mate:103, Mate:163
156. ISO 4032 M5:10 — Mate:100, Mate:103
157. Plain Washer (Metric) 5 N:3 — Mate:163, Mate:164, Mate:100
158. ISO 4762 M5 x 20:5 — Insert:15, Mate:88, Mate:167
159. ISO 4032 M5:6 — Mate:88, Mate:89
160. Plain Washer (Metric) 5 N:5 — Mate:167, Mate:168, Mate:89
161. ISO 4762 M5 x 20:6 — Insert:16, Mate:90, Mate:166
162. ISO 4032 M5:7 — Mate:90, Mate:95
163. Plain Washer (Metric) 5 N:4 — Mate:166, Mate:169, Mate:95
164. ISO 4762 M5 x 20:10 — Insert:31, Mate:102, Mate:165
165. ISO 4032 M5:12 — Mate:98, Mate:102
166. Plain Washer (Metric) 5 N:6 — Mate:165, Mate:170, Mate:98
167. ISO 4762 M5 x 20:7 — Insert:17, Mate:92, Mate:172
168. ISO 4032 M5:9 — Mate:92, Mate:93
169. Plain Washer (Metric) 5 N:8 — Mate:172, Mate:177, Mate:93
170. ISO 4762 M5 x 20:8 — Insert:18, Mate:91, Mate:173
171. ISO 4032 M5:8 — Mate:91, Mate:94
172. Plain Washer (Metric) 5 N:10 — Mate:173, Mate:176, Mate:94
173. ISO 4762 M5 x 20:12 — Insert:32, Mate:101, Mate:171
174. ISO 4032 M5:11 — Mate:99, Mate:101
175. Plain Washer (Metric) 5 N:9 — Mate:171, Mate:178, Mate:99
176. ISO 4762 M5 x 20:9 — Insert:29, Mate:96, Mate:174
177. ISO 4032 M5:5 — Mate:96, Mate:97
178. Plain Washer (Metric) 5 N:7 — Mate:174, Mate:175, Mate:97
179. KP08 Pillow block bearing 08mm diameter:1 — Mate:47, Mate:48, Mate:49, Insert:13, Insert:14
180. ISO 4762 M4 x 16:1 — Insert:13
181. Bearing Spacer:1 — Mate:50, Mate:51, Mate:52, Mate:219
182. ISO 4762 M4 x 16:2 — Insert:14
183. Linear Guide Rods:2 — Mate:29, Mate:30, Mate:35
184. Linear Guide Rods:1 — Mate:32, Mate:34, Mate:36, Mate:46
185. SHF8:1 — Mate:19, Mate:20, Mate:21, Mate:22, Insert:5, Insert:6, Insert:43, Insert:44
186. SHF8_MIR:1 — Mate:26, Mate:27, Mate:28, Insert:7, Insert:8, Insert:45, Insert:46
187. SK8 Linear Shaft Support, 8mm v4:1 — Mate:18, Mate:29, Mate:41, Mate:42, Insert:9, Insert:10, Insert:39, Insert:40
188. SK8 Linear Shaft Support, 8mm v4:2 — Mate:43, Mate:44, Mate:45, Mate:46, Insert:11, Insert:12, Insert:41, Insert:42
189. Insert M5 D7 L9.5mm:1 — Mate:53, Flush:7
190. Insert M5 D7 L9.5mm:2 — Mate:54, Flush:8
191. Insert M5 D7 L9.5mm:3 — Mate:55, Flush:9
192. Insert M5 D7 L9.5mm:4 — Mate:56, Flush:10
193. Insert M5 D7 L9.5mm:5 — Mate:58, Flush:13
194. Insert M5 D7 L9.5mm:6 — Mate:57, Flush:14
195. Insert M5 D7 L9.5mm:7 — Mate:59, Flush:11
196. Insert M5 D7 L9.5mm:8 — Mate:60, Flush:12
197. ISO 4762 M5 x 20:1 — Insert:5
198. Plain Washer (Metric) 5 N:15 — Insert:43
199. ISO 4762 M5 x 20:2 — Insert:6
200. Plain Washer (Metric) 5 N:16 — Insert:44
201. ISO 4762 M5 x 20:3 — Insert:7
202. Plain Washer (Metric) 5 N:18 — Insert:45
203. ISO 4762 M5 x 20:4 — Insert:8
204. Plain Washer (Metric) 5 N:17 — Insert:46
205. ISO 4762 M5 x 16:4 — Insert:11
206. Plain Washer (Metric) 5 N:13 — Insert:41
207. ISO 4762 M5 x 16:3 — Insert:12
208. Plain Washer (Metric) 5 N:14 — Insert:42
209. Plain Washer (Metric) 5 N:12 — Insert:40
210. ISO 4762 M5 x 16:2 — Insert:10
211. Plain Washer (Metric) 5 N:11 — Insert:39
212. ISO 4762 M5 x 16:1 — Insert:9
213. Drag Chain Middle Link:1 — Mate:447, Angle:23
214. Drag Chain Middle Link:2
215. Drag Chain Middle Link:3
216. Drag Chain Middle Link:4
217. Drag Chain Middle Link:5
218. Drag Chain Middle Link:6
219. Drag Chain Middle Link:7
220. Drag Chain Middle Link:8
221. Drag Chain Middle Link:9
222. Drag Chain Middle Link:10
223. Drag Chain Middle Link:11
224. Drag Chain Middle Link:12
225. Drag Chain Middle Link:13
226. Drag Chain Middle Link:14
227. Drag Chain Middle Link:15
228. Drag Chain Middle Link:16
229. Drag Chain Middle Link:17
230. Drag Chain Middle Link:18
231. Drag Chain Middle Link:19
232. Drag Chain Middle Link:20
233. Drag Chain Middle Link:21
234. Drag Chain Middle Link:22
235. Drag Chain Middle Link:23
236. Drag Chain Middle Link:24
237. Drag Chain Middle Link:25
238. Drag Chain Middle Link:26
239. Drag Chain Middle Link:27
240. LimitSwitchMountPlate:1 — Mate:372, Mate:373, Mate:374, Mate:375, Mate:376, Mate:377, Mate:378, Mate:422, Mate:427, Mate:428, Mate:429, Mate:440, Mate:441, Mate:530
241. NO-NC Bump Switch:5 — Mate:375, Mate:376, Mate:377, Mate:436, Mate:437, Mate:438, Mate:439
242. Slider T-Nut for 2020 - M3:3 — Mate:424, Angle:22, Mate:426, Mate:428
243. Slider T-Nut for 2020 - M3:4 — Mate:422, Mate:423, Angle:21, Mate:425
244. ISO 4762 M3 x 10:2 — Mate:425
245. ISO 4762 M3 x 10:1 — Mate:426
246. Plain Washer (Metric) 3 N:11 — Mate:427
247. Plain Washer (Metric) 3 N:12 — Mate:429
248. ISO 4762 M2 x 16:7 — Mate:436
249. ISO 4032 M2:8 — Mate:441
250. Plain Washer (Metric) 2 N:15 — Mate:438
251. ISO 4762 M2 x 16:8 — Mate:437
252. ISO 4032 M2:9 — Mate:440
253. Plain Washer (Metric) 2 N:16 — Mate:439
254. LimitSwitchMountPlate_MIR:1
255. NO-NC Bump Switch_MIR:1
256. Slider T-Nut for 2020 - M3_MIR:1
257. Slider T-Nut for 2020 - M3_MIR:2
258. ISO 4762 M3 x 10:3
259. ISO 4762 M3 x 10:4
260. Plain Washer (Metric) 3 N:24
261. Plain Washer (Metric) 3 N:25
262. ISO 4762 M2 x 16:9
263. ISO 4032 M2:10
264. Plain Washer (Metric) 2 N:17
265. ISO 4762 M2 x 16:10
266. ISO 4032 M2:11
267. Plain Washer (Metric) 2 N:18
## Component patterns: (27 elements, first: Drag Chain Middle Link:1), (2 elements, first: LimitSwitchMountPlate:1 + NO-NC Bump Switch:5 + Slider T-Nut for 2020 - M3:3 + Slider T-Nut for 2020 - M3:4 + ISO 4762 M3 x 10:2 + ISO 4762 M3 x 10:1 + Plain Washer (Metric) 3 N:11 + Plain Washer (Metric) 3 N:12 + ISO 4762 M2 x 16:7 + ISO 4032 M2:8 + Plain Washer (Metric) 2 N:15 + ISO 4762 M2 x 16:8 + ISO 4032 M2:9 + Plain Washer (Metric) 2 N:16)
## Relationships (451: Mate 358, Insert 51, Flush 23, Angle 14, Tangent 4, Symmetry 1)
- Insert:2: 127x88 Gantry:1 ↔ V-Pulley:1
- Insert:4: 127x88 Gantry:1 ↔ V-Pulley:2
- Mate:2: Z Bracket:1 ↔ 127x88 Gantry:1
- Mate:3: Z Bracket:1 ↔ 127x88 Gantry:1
- Mate:4: Z Bracket:1 ↔ 127x88 Gantry:1
- Mate:7: 17HS4401:1 ↔ Z Bracket:1
- Mate:8: 17HS4401:1 ↔ Flexible_Shaft_Coupling_5_to_8mm v7:1
- Mate:10: Flexible_Shaft_Coupling_5_to_8mm v7:1 ↔ Z Bracket:1
- Mate:12: Flexible_Shaft_Coupling_5_to_8mm v7:1 ↔ Trapezoidal lead screw tr8x8-4:1
- Mate:18: Z Bracket:1 ↔ SK8 Linear Shaft Support, 8mm v4:1
- Mate:19: Z Bracket:1 ↔ SHF8:1
- Mate:20: Z Bracket:1 ↔ SHF8:1
- Mate:21: Z Bracket:1 ↔ SHF8:1
- Mate:22: Z Bracket:1 ↔ SHF8:1
- Mate:26: Z Bracket:1 ↔ SHF8_MIR:1
- Mate:27: Z Bracket:1 ↔ SHF8_MIR:1
- Mate:28: Z Bracket:1 ↔ SHF8_MIR:1
- Mate:29: Linear Guide Rods:2 ↔ SK8 Linear Shaft Support, 8mm v4:1
- Mate:30: Z Bracket:1 ↔ Linear Guide Rods:2
- Mate:32: Z Bracket:1 ↔ Linear Guide Rods:1
- Mate:33: Flexible_Shaft_Coupling_5_to_8mm v7:1 ↔ Trapezoidal lead screw tr8x8-4:1
- Mate:34: SCS8UU Block, Linear Bearing, 8mm:1 ↔ Linear Guide Rods:1
- Mate:35: SCS8UU Block, Linear Bearing, 8mm:2 ↔ Linear Guide Rods:2
- Mate:36: Linear Guide Rods:1
- Mate:37
- Angle:6 (90 deg): Z Bracket:1
- Mate:38: Z Bracket:1
- Mate:39
- Angle:7 (90 deg): Z Bracket:1
- Mate:41: Z Bracket:1 ↔ SK8 Linear Shaft Support, 8mm v4:1
- Mate:42: Z Bracket:1 ↔ SK8 Linear Shaft Support, 8mm v4:1
- Mate:43: Z Bracket:1 ↔ SK8 Linear Shaft Support, 8mm v4:2
- Mate:44: Z Bracket:1 ↔ SK8 Linear Shaft Support, 8mm v4:2
- Mate:45: Z Bracket:1 ↔ SK8 Linear Shaft Support, 8mm v4:2
- Mate:46: Linear Guide Rods:1 ↔ SK8 Linear Shaft Support, 8mm v4:2
- Mate:47: Z Bracket:1 ↔ KP08 Pillow block bearing 08mm diameter:1
- Mate:48: Z Bracket:1 ↔ KP08 Pillow block bearing 08mm diameter:1
- Mate:49: Z Bracket:1 ↔ KP08 Pillow block bearing 08mm diameter:1
- Mate:50: Z Bracket:1 ↔ Bearing Spacer:1
- Mate:51: Z Bracket:1 ↔ Bearing Spacer:1
- Mate:52: Z Bracket:1 ↔ Bearing Spacer:1
- Mate:53: Z Bracket:1 ↔ Insert M5 D7 L9.5mm:1
- Flush:7: Z Bracket:1 ↔ Insert M5 D7 L9.5mm:1
- Mate:54: Z Bracket:1 ↔ Insert M5 D7 L9.5mm:2
- Flush:8: Z Bracket:1 ↔ Insert M5 D7 L9.5mm:2
- Mate:55: Z Bracket:1 ↔ Insert M5 D7 L9.5mm:3
- Flush:9: Z Bracket:1 ↔ Insert M5 D7 L9.5mm:3
- Mate:56: Z Bracket:1 ↔ Insert M5 D7 L9.5mm:4
- Flush:10: Z Bracket:1 ↔ Insert M5 D7 L9.5mm:4
- Mate:57: Z Bracket:1 ↔ Insert M5 D7 L9.5mm:6
- Mate:58: Z Bracket:1 ↔ Insert M5 D7 L9.5mm:5
- Mate:59: Z Bracket:1 ↔ Insert M5 D7 L9.5mm:7
- Mate:60: Z Bracket:1 ↔ Insert M5 D7 L9.5mm:8
- Flush:11: Z Bracket:1 ↔ Insert M5 D7 L9.5mm:7
- Flush:12: Z Bracket:1 ↔ Insert M5 D7 L9.5mm:8
- Flush:13: Z Bracket:1 ↔ Insert M5 D7 L9.5mm:5
- Flush:14: Z Bracket:1 ↔ Insert M5 D7 L9.5mm:6
- Mate:61: Z Bracket:1 ↔ M4 Insert:1
- Mate:62: Z Bracket:1 ↔ M4 Insert:2
- Flush:15: Z Bracket:1 ↔ M4 Insert:2
- Flush:16: Z Bracket:1 ↔ M4 Insert:1
- Insert:5 (1.4 mm): SHF8:1 ↔ ISO 4762 M5 x 20:1
- Insert:6 (1.4 mm): SHF8:1 ↔ ISO 4762 M5 x 20:2
- Insert:7 (1.4 mm): SHF8_MIR:1 ↔ ISO 4762 M5 x 20:3
- Insert:8 (1.4 mm): SHF8_MIR:1 ↔ ISO 4762 M5 x 20:4
- Insert:9 (1.4 mm): SK8 Linear Shaft Support, 8mm v4:1 ↔ ISO 4762 M5 x 16:1
- Insert:10 (1.4 mm): SK8 Linear Shaft Support, 8mm v4:1 ↔ ISO 4762 M5 x 16:2
- Insert:11 (1.4 mm): SK8 Linear Shaft Support, 8mm v4:2 ↔ ISO 4762 M5 x 16:4
- Insert:12 (1.4 mm): SK8 Linear Shaft Support, 8mm v4:2 ↔ ISO 4762 M5 x 16:3
- Insert:13: KP08 Pillow block bearing 08mm diameter:1 ↔ ISO 4762 M4 x 16:1
- Insert:14: KP08 Pillow block bearing 08mm diameter:1 ↔ ISO 4762 M4 x 16:2
- Insert:15: Z Bracket:1 ↔ ISO 4762 M5 x 20:5
- Insert:16: Z Bracket:1 ↔ ISO 4762 M5 x 20:6
- Insert:17: Z Bracket:1 ↔ ISO 4762 M5 x 20:7
- Insert:18: Z Bracket:1 ↔ ISO 4762 M5 x 20:8
- Insert:23: Z Bracket:1 ↔ ISO 4762 M3 x 16:8
- Insert:24: Z Bracket:1 ↔ ISO 4762 M3 x 16:9
- Insert:25: Z Bracket:1 ↔ ISO 4762 M3 x 16:10
- Insert:26: Z Bracket:1 ↔ ISO 4762 M3 x 16:11
- Mate:75: SCS8UU Block, Linear Bearing, 8mm:2 ↔ Linear Bearing Spacer:2
- Mate:76: SCS8UU Block, Linear Bearing, 8mm:2 ↔ Linear Bearing Spacer:2
- Mate:78: SCS8UU Block, Linear Bearing, 8mm:1 ↔ Linear Bearing Spacer:1
- Insert:27: 127x88 Gantry:1 ↔ V-Pulley:4
- Insert:28: 127x88 Gantry:1 ↔ V-Pulley:3
- Tangent:9: 2020aluminum_extrusion_black:1 ↔ V-Pulley:4
- Tangent:10: 2020aluminum_extrusion_black:1 ↔ V-Pulley:4
- Tangent:11: 2020aluminum_extrusion_black:1 ↔ V-Pulley:3
- Tangent:12: 2020aluminum_extrusion_black:1 ↔ V-Pulley:3
- Mate:84: T8 nut:1 ↔ ISO 4762 M3 x 12:1
- Mate:85: T8 nut:1 ↔ ISO 4762 M3 x 12:2
- Mate:86: T8 nut:1 ↔ ISO 4762 M3 x 12:2
- Mate:87: T8 nut:1 ↔ ISO 4762 M3 x 12:1
- Mate:88: ISO 4762 M5 x 20:5 ↔ ISO 4032 M5:6
- Mate:89: ISO 4032 M5:6 ↔ Plain Washer (Metric) 5 N:5
- Mate:90: ISO 4762 M5 x 20:6 ↔ ISO 4032 M5:7
- Mate:91: ISO 4762 M5 x 20:8 ↔ ISO 4032 M5:8
- Mate:92: ISO 4762 M5 x 20:7 ↔ ISO 4032 M5:9
- Mate:93: ISO 4032 M5:9 ↔ Plain Washer (Metric) 5 N:8
- Mate:94: ISO 4032 M5:8 ↔ Plain Washer (Metric) 5 N:10
- Mate:95: ISO 4032 M5:7 ↔ Plain Washer (Metric) 5 N:4
- Insert:29: Z Bracket:1 ↔ ISO 4762 M5 x 20:9
- Insert:30: Z Bracket:1 ↔ ISO 4762 M5 x 20:11
- Insert:31: Z Bracket:1 ↔ ISO 4762 M5 x 20:10
- Insert:32: Z Bracket:1 ↔ ISO 4762 M5 x 20:12
- Mate:96: ISO 4762 M5 x 20:9 ↔ ISO 4032 M5:5
- Mate:97: ISO 4032 M5:5 ↔ Plain Washer (Metric) 5 N:7
- Mate:98: ISO 4032 M5:12 ↔ Plain Washer (Metric) 5 N:6
- Mate:99: ISO 4032 M5:11 ↔ Plain Washer (Metric) 5 N:9
- Mate:100: ISO 4032 M5:10 ↔ Plain Washer (Metric) 5 N:3
- Mate:101: ISO 4762 M5 x 20:12 ↔ ISO 4032 M5:11
- Mate:102: ISO 4762 M5 x 20:10 ↔ ISO 4032 M5:12
- Mate:103: ISO 4762 M5 x 20:11 ↔ ISO 4032 M5:10
- Mate:108: Linear Bearing Spacer:2 ↔ Suction Cup Fixation:1
- Mate:110: SK12 SHAFT HOLDER:1 ↔ Suction Cup Fixation:1
- Mate:111: SK12 SHAFT HOLDER:1 ↔ Suction Cup Fixation:1
- Mate:112: SK12 SHAFT HOLDER:1 ↔ Suction Cup Fixation:1
- Mate:113: SK12 SHAFT HOLDER:1 ↔ Suction:1
- Mate:114 (4 mm): SK12 SHAFT HOLDER:1 ↔ Suction:1
- Mate:118: Suction Cup Fixation:1 ↔ ISO 4762 M4 x 12:2
- Mate:119: Suction Cup Fixation:1 ↔ ISO 4762 M4 x 12:1
- Mate:120: Suction Cup Fixation:1 ↔ ISO 4762 M4 x 12:2
- Mate:121: Suction Cup Fixation:1 ↔ ISO 4762 M4 x 12:1
- Mate:122: Suction Cup Fixation:1 ↔ ISO 4762 M4 x 12:4
- Mate:123: Suction Cup Fixation:1 ↔ ISO 4762 M4 x 12:3
- Mate:124: Suction Cup Fixation:1 ↔ ISO 4762 M4 x 12:3
- Mate:125: Suction Cup Fixation:1 ↔ ISO 4762 M4 x 12:4
- Mate:126: Suction Cup Fixation:1 ↔ ISO 4762 M4 x 8:3
- Mate:127: Suction Cup Fixation:1 ↔ ISO 4762 M4 x 8:3
- Mate:128: Suction Cup Fixation:1 ↔ ISO 4762 M4 x 8:4
- Mate:129: Suction Cup Fixation:1 ↔ ISO 4762 M4 x 8:4
- Mate:130: Suction Cup Fixation:1 ↔ ISO 4762 M4 x 16:6